# Autodesk Inventor assembly: Robot Disinfectan
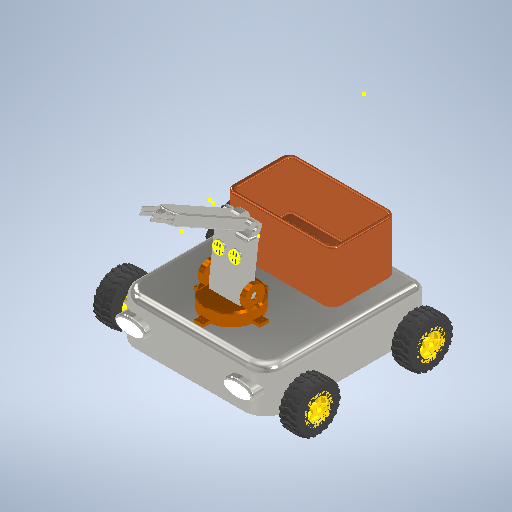
[picture p0: Inventor's stored thumbnail of the model, 512x512]
Saved by Autodesk Inventor 2025 (Build 290162000, 162)
## iProperties
Created: 2025-12-07
Part Number: Robot Disinfectan
Document SubType Name: Assembly
Designer: novsa
Author: novsa
## Documents named in this file (9)
- C:\Users\novsa.4SUS\Downloads\Robot Disinfectan.iam
- C:\Users\novsa.4SUS\Downloads\Body robot disinfectan.ipt
- C:\Users\novsa.4SUS\Downloads\part roda.iam
- C:\Users\novsa.4SUS\OneDrive\Dokumen\Rev 3.ipt
- C:\Users\novsa.4SUS\OneDrive\Dokumen\Rev 2.ipt
- C:\Users\novsa.4SUS\Downloads\Rev 1.ipt
- C:\Users\novsa.4SUS\OneDrive\Dokumen\Rev 5.ipt
- C:\Users\novsa.4SUS\OneDrive\Dokumen\Rev 4.ipt
- C:\Users\novsa.4SUS\OneDrive\Dokumen\Kotak Sampah.ipt
## Components (11 placed, 8 different names)
1. Body robot disinfectan:2 — Insert:1, Insert:2, Insert:3, Insert:4, Rigid:1, Rigid:2, Rigid:3
2. part roda:1 [sub-assembly] — Insert:4
3. part roda:2 [sub-assembly] — Insert:3
4. part roda:3 [sub-assembly] — Insert:2
5. part roda:4 [sub-assembly] — Insert:1
6. Rev 3:1 — Rigid:1, Rotational:1
7. Rev 2:1 — Rotational:1, Rotational:2
8. Rev 1:3 — Rotational:2
9. Rev 5:1
10. Rev 4:1 — Rigid:2
11. Kotak Sampah:1 — Rigid:3
## Relationships (9: Insert 4, WeldJoint 3, RevoluteJoint 2)
- Insert:1: Body robot disinfectan:2 ↔ part roda:4
- Insert:2: Body robot disinfectan:2 ↔ part roda:3
- Insert:3: Body robot disinfectan:2 ↔ part roda:2
- Insert:4: Body robot disinfectan:2 ↔ part roda:1
- Rigid:1 [WeldJoint]: Body robot disinfectan:2 ↔ Rev 3:1
- Rotational:1 [RevoluteJoint] (-14.2875 mm): Rev 3:1 ↔ Rev 2:1
- Rotational:2 [RevoluteJoint] (-17.4625 mm): Rev 2:1 ↔ Rev 1:3
- Rigid:2 [WeldJoint]: Body robot disinfectan:2 ↔ Rev 4:1
- Rigid:3 [WeldJoint]: Body robot disinfectan:2 ↔ Kotak Sampah:1
